# Autodesk Inventor assembly: Ensamblaje version 2
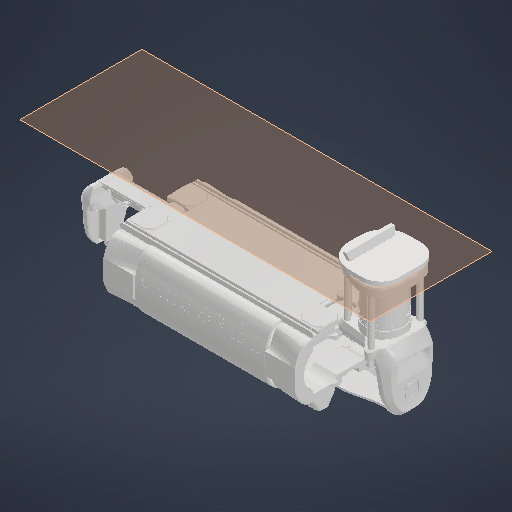
[picture p0: Inventor's stored thumbnail of the model, 512x512]
Saved by Autodesk Inventor 2027.2 (Build 312334000, 334)
## iProperties
Created: 2026-11-05
Part Number: Ensamblaje version 2
Document SubType Name: Assembly
Designer: Jaime
Author: Jaime
## Documents named in this file (3)
- C:\Users\Jaime\AppData\Roaming\Microsoft\Windows\Network Shortcuts\UTP\Robot B2\Ensamblaje version 2.iam
- C:\Users\Jaime\AppData\Roaming\Microsoft\Windows\Network Shortcuts\UTP\Robot B2\base B2.ipt
- C:\Users\Jaime\AppData\Roaming\Microsoft\Windows\Network Shortcuts\UTP\Robot B2\montura.ipt
## Components (2 placed, 2 different names)
1. base B2:1 — Nivelación:1
2. montura:1 — Nivelación:2, Nivelación:3
## Relationships (3: Flush 3)
- Nivelación:1 [Flush] (10 mm): base B2:1
- Nivelación:2 [Flush]: montura:1
- Nivelación:3 [Flush]: montura:1
